# Autodesk Inventor assembly: p1-p2-v2
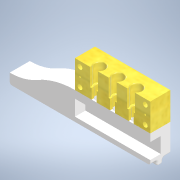
[picture p0: Inventor's stored thumbnail of the model, 180x180]
Saved by Autodesk Inventor 2020 (Build 240168000, 168)
## iProperties
Created: 2022-06-16
Part Number: p1-p2-v2
Document SubType Name: Assembly
Designer: drago
Author: drago
## Documents named in this file (3)
- C:\Users\drago\Documents\ULTIMA_VARIANTA\Assembly\p1-p2-v2.iam
- C:\Users\drago\Documents\ULTIMA_VARIANTA\Broasca\Broascav2\P2_V2_001.ipt
- C:\Users\drago\Documents\ULTIMA_VARIANTA\Suporti Cuie\Suport Cuie Varianta 2 + PDF pt DAN sa faca cheile - Copy\P1_V2_001.ipt
## Components (2 placed, 2 different names)
1. P2_V2_001:1 — Mate:1, Flush:1, Flush:2
2. P1_V2_001:1 — Mate:1, Flush:1, Flush:2
## Relationships (3: Flush 2, Mate 1)
- Mate:1: P2_V2_001:1 ↔ P1_V2_001:1
- Flush:1: P2_V2_001:1 ↔ P1_V2_001:1
- Flush:2: P2_V2_001:1 ↔ P1_V2_001:1
